# Autodesk Inventor assembly: S6  22.2v - 5200 60C maH
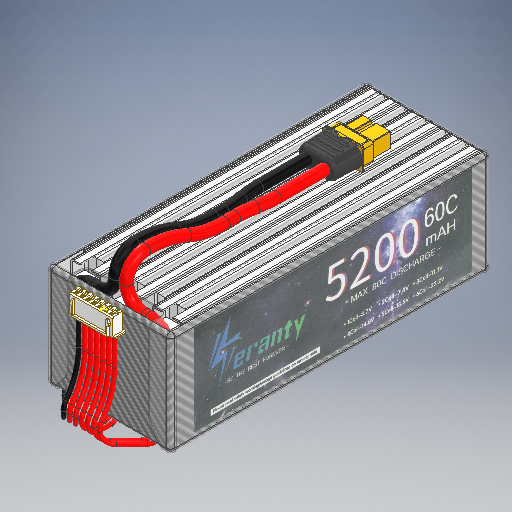
[picture p0: Inventor's stored thumbnail of the model, 512x512]
Saved by Autodesk Inventor 2025 (Build 290162010, 162A)
## iProperties
Created: 2025-08-20
Part Number: S6  22.2v - 5200 60C maH
Document SubType Name: Assembly
Designer: Glen Collingwood
Author: Glen Collingwood
## Documents named in this file (6)
- D:\MISCELLANEOUS\Inventor Projects\SSN 744 Block V (1-100)\Battery\S6  22.2v - 5200 60C maH.iam
- D:\MISCELLANEOUS\Inventor Projects\SSN 744 Block V (1-100)\Battery\3.7v Cell.ipt
- D:\MISCELLANEOUS\Inventor Projects\SSN 744 Block V (1-100)\Battery\Wrapper.ipt
- D:\MISCELLANEOUS\Inventor Projects\SSN 744 Block V (1-100)\Battery\Shrink Wrap.ipt
- D:\MISCELLANEOUS\Inventor Projects\SSN 744 Block V (1-100)\Battery\Power Cable Assembly.iam
- D:\MISCELLANEOUS\Inventor Projects\SSN 744 Block V (1-100)\Connectors\Charging Cable Assembly.iam
## Components (10 placed, 5 different names)
1. 3.7v Cell:1 — Flush:1, Flush:2, Flush:3, Mate:1, Mate:2, Flush:4, Mate:4, Flush:7, Flush:8, Flush:9
2. 3.7v Cell:2 — Mate:1, Mate:2, Flush:4, Mate:3, Flush:5, Flush:6
3. 3.7v Cell:3 — Mate:3, Flush:5, Flush:6
4. 3.7v Cell:4 — Mate:4, Flush:7, Flush:8, Mate:5, Flush:9, Flush:10, Flush:11
5. 3.7v Cell:5 — Mate:5, Flush:10, Flush:11, Mate:6, Flush:12, Flush:13, Mate:8
6. 3.7v Cell:6 — Mate:6, Flush:12, Flush:13
7. Wrapper:1 — Mate:7, Flush:14, Mate:8, Mate:9
8. Shrink Wrap:1 — Flush:15, Flush:16, Mate:9, Mate:10, Mate:13
9. Power Cable Assembly:1 [sub-assembly] — Flush:17, Mate:10, Mate:11
10. Charging Cable Assembly:1 [sub-assembly] — Flush:18, Mate:12, Mate:13
## Relationships (31: Flush 18, Mate 13)
- Flush:1: 3.7v Cell:1
- Flush:2: 3.7v Cell:1
- Flush:3: 3.7v Cell:1
- Mate:1: 3.7v Cell:1 ↔ 3.7v Cell:2
- Mate:2: 3.7v Cell:1 ↔ 3.7v Cell:2
- Flush:4: 3.7v Cell:1 ↔ 3.7v Cell:2
- Mate:3: 3.7v Cell:2 ↔ 3.7v Cell:3
- Flush:5: 3.7v Cell:2 ↔ 3.7v Cell:3
- Flush:6: 3.7v Cell:2 ↔ 3.7v Cell:3
- Mate:4: 3.7v Cell:1 ↔ 3.7v Cell:4
- Flush:7: 3.7v Cell:1 ↔ 3.7v Cell:4
- Flush:8: 3.7v Cell:1 ↔ 3.7v Cell:4
- Mate:5: 3.7v Cell:4 ↔ 3.7v Cell:5
- Flush:9: 3.7v Cell:1 ↔ 3.7v Cell:4
- Flush:10: 3.7v Cell:4 ↔ 3.7v Cell:5
- Flush:11: 3.7v Cell:4 ↔ 3.7v Cell:5
- Mate:6: 3.7v Cell:5 ↔ 3.7v Cell:6
- Flush:12: 3.7v Cell:5 ↔ 3.7v Cell:6
- Flush:13: 3.7v Cell:5 ↔ 3.7v Cell:6
- Mate:7: Wrapper:1
- Flush:14: Wrapper:1
- Mate:8: 3.7v Cell:5 ↔ Wrapper:1
- Flush:15: Shrink Wrap:1
- Flush:16: Shrink Wrap:1
- Mate:9: Wrapper:1 ↔ Shrink Wrap:1
- Flush:17: Power Cable Assembly:1
- Mate:10 (1 mm): Shrink Wrap:1 ↔ Power Cable Assembly:1
- Mate:11 (35 mm): Power Cable Assembly:1
- Flush:18 (1.25 mm): Charging Cable Assembly:1
- Mate:12 (15 mm): Charging Cable Assembly:1
- Mate:13 (1 mm): Shrink Wrap:1 ↔ Charging Cable Assembly:1
